# Autodesk Inventor assembly: 24567474
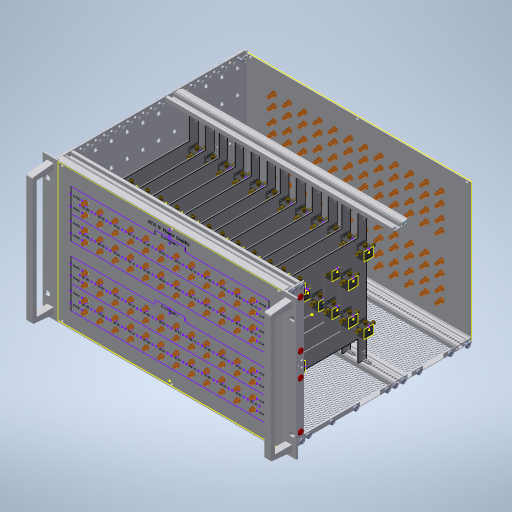
[picture p0: Inventor's stored thumbnail of the model, 512x512]
Saved by Autodesk Inventor 2024 (Build 280153000, 153)
## iProperties
Company: TraceParts S.A.
Created: 2016-07-14
Part Number: 24567474
Checked By: TraceParts S.A.
Catalog Web Link: www.traceparts.com
Description: Kit, "heavy", shielded, for backplane mounting
Vendor: Pentair/Schroff
Document SubType Name: Assembly
Designer: TraceParts
REFERENCE: 24567474
SUPPLIER: Pentair/Schroff
DESIGN: Kit, "heavy", shielded, for backplane mounting
OMNICLASS23: 23.35.33.15
TraceParts.PartVersion: 1.1.6
TraceParts.PartStatus: Published
TraceParts.PartNumber: 30-07022014-089200
TraceParts.PartLanguage: en
TraceParts.InstanceId: 30-07022014-0892005HIZ0WY7A405UN62VUZ05UA7U
TraceParts.PartTitle: Kit, "heavy", shielded, for backplane mounting
TRACEPARTS: TRACEPARTS
TraceParts.ClassPath: SCHROFF:/F_SCHROFF/SCHROFF.1/SCHROFF.1.1./SCHROFF.1.1.1/30-07022014-089200
Title: Kit, "heavy", shielded, for backplane mounting
Author: TraceParts
## Documents named in this file (110)
- C:\Users\Alexander Pollak\ownCloud\Inventor\ATA_2019\ATA_IF_PowerSplitter_6U\24567474.iam
- C:\Users\Alexander Pollak\ownCloud\Inventor\ATA_2019\ATA_IF_PowerSplitter_6U\24567474_106.ipt
- C:\Users\Alexander Pollak\ownCloud\Inventor\ATA_2019\ATA_IF_PowerSplitter_6U\24567474_105.ipt
- C:\Users\Alexander Pollak\ownCloud\Inventor\ATA_2019\ATA_IF_PowerSplitter_6U\24567474_104.ipt
- C:\Users\Alexander Pollak\ownCloud\Inventor\ATA_2019\ATA_IF_PowerSplitter_6U\24567474_103.ipt
- C:\Users\Alexander Pollak\ownCloud\Inventor\ATA_2019\ATA_IF_PowerSplitter_6U\24567474_102.ipt
- C:\Users\Alexander Pollak\ownCloud\Inventor\ATA_2019\ATA_IF_PowerSplitter_6U\24567474_101.ipt
- C:\Users\Alexander Pollak\ownCloud\Inventor\ATA_2019\ATA_IF_PowerSplitter_6U\24567474_100.ipt
- C:\Users\Alexander Pollak\ownCloud\Inventor\ATA_2019\ATA_IF_PowerSplitter_6U\24567474_99.ipt
- C:\Users\Alexander Pollak\ownCloud\Inventor\ATA_2019\ATA_IF_PowerSplitter_6U\24567474_98.ipt
- C:\Users\Alexander Pollak\ownCloud\Inventor\ATA_2019\ATA_IF_PowerSplitter_6U\24567474_97.ipt
- C:\Users\Alexander Pollak\ownCloud\Inventor\ATA_2019\ATA_IF_PowerSplitter_6U\24567474_96.ipt
- C:\Users\Alexander Pollak\ownCloud\Inventor\ATA_2019\ATA_IF_PowerSplitter_6U\24567474_95.ipt
- C:\Users\Alexander Pollak\ownCloud\Inventor\ATA_2019\ATA_IF_PowerSplitter_6U\24567474_94.ipt
- C:\Users\Alexander Pollak\ownCloud\Inventor\ATA_2019\ATA_IF_PowerSplitter_6U\24567474_93.ipt
- C:\Users\Alexander Pollak\ownCloud\Inventor\ATA_2019\ATA_IF_PowerSplitter_6U\24567474_92.ipt
- C:\Users\Alexander Pollak\ownCloud\Inventor\ATA_2019\ATA_IF_PowerSplitter_6U\24567474_91.ipt
- C:\Users\Alexander Pollak\ownCloud\Inventor\ATA_2019\ATA_IF_PowerSplitter_6U\24567474_90.ipt
- C:\Users\Alexander Pollak\ownCloud\Inventor\ATA_2019\ATA_IF_PowerSplitter_6U\24567474_89.ipt
- C:\Users\Alexander Pollak\ownCloud\Inventor\ATA_2019\ATA_IF_PowerSplitter_6U\24567474_88.ipt
- C:\Users\Alexander Pollak\ownCloud\Inventor\ATA_2019\ATA_IF_PowerSplitter_6U\24567474_87.ipt
- C:\Users\Alexander Pollak\ownCloud\Inventor\ATA_2019\ATA_IF_PowerSplitter_6U\24567474_86.ipt
- C:\Users\Alexander Pollak\ownCloud\Inventor\ATA_2019\ATA_IF_PowerSplitter_6U\24567474_85.ipt
- C:\Users\Alexander Pollak\ownCloud\Inventor\ATA_2019\ATA_IF_PowerSplitter_6U\24567474_84.ipt
- C:\Users\Alexander Pollak\ownCloud\Inventor\ATA_2019\ATA_IF_PowerSplitter_6U\24567474_83.ipt
- C:\Users\Alexander Pollak\ownCloud\Inventor\ATA_2019\ATA_IF_PowerSplitter_6U\24567474_82.ipt
- C:\Users\Alexander Pollak\ownCloud\Inventor\ATA_2019\ATA_IF_PowerSplitter_6U\24567474_81.ipt
- C:\Users\Alexander Pollak\ownCloud\Inventor\ATA_2019\ATA_IF_PowerSplitter_6U\24567474_80.ipt
- C:\Users\Alexander Pollak\ownCloud\Inventor\ATA_2019\ATA_IF_PowerSplitter_6U\24567474_79.ipt
- C:\Users\Alexander Pollak\ownCloud\Inventor\ATA_2019\ATA_IF_PowerSplitter_6U\24567474_78.ipt
- C:\Users\Alexander Pollak\ownCloud\Inventor\ATA_2019\ATA_IF_PowerSplitter_6U\24567474_77.ipt
- C:\Users\Alexander Pollak\ownCloud\Inventor\ATA_2019\ATA_IF_PowerSplitter_6U\24567474_76.ipt
- C:\Users\Alexander Pollak\ownCloud\Inventor\ATA_2019\ATA_IF_PowerSplitter_6U\24567474_75.ipt
- C:\Users\Alexander Pollak\ownCloud\Inventor\ATA_2019\ATA_IF_PowerSplitter_6U\24567474_74.ipt
- C:\Users\Alexander Pollak\ownCloud\Inventor\ATA_2019\ATA_IF_PowerSplitter_6U\24567474_73.ipt
- C:\Users\Alexander Pollak\ownCloud\Inventor\ATA_2019\ATA_IF_PowerSplitter_6U\24567474_72.ipt
- C:\Users\Alexander Pollak\ownCloud\Inventor\ATA_2019\ATA_IF_PowerSplitter_6U\24567474_71.ipt
- C:\Users\Alexander Pollak\ownCloud\Inventor\ATA_2019\ATA_IF_PowerSplitter_6U\24567474_70.ipt
- C:\Users\Alexander Pollak\ownCloud\Inventor\ATA_2019\ATA_IF_PowerSplitter_6U\24567474_69.ipt
- C:\Users\Alexander Pollak\ownCloud\Inventor\ATA_2019\ATA_IF_PowerSplitter_6U\24567474_68.ipt
- C:\Users\Alexander Pollak\ownCloud\Inventor\ATA_2019\ATA_IF_PowerSplitter_6U\24567474_67.ipt
- C:\Users\Alexander Pollak\ownCloud\Inventor\ATA_2019\ATA_IF_PowerSplitter_6U\24567474_66.ipt
- C:\Users\Alexander Pollak\ownCloud\Inventor\ATA_2019\ATA_IF_PowerSplitter_6U\24567474_65.ipt
- C:\Users\Alexander Pollak\ownCloud\Inventor\ATA_2019\ATA_IF_PowerSplitter_6U\24567474_64.ipt
- C:\Users\Alexander Pollak\ownCloud\Inventor\ATA_2019\ATA_IF_PowerSplitter_6U\24567474_63.ipt
- C:\Users\Alexander Pollak\ownCloud\Inventor\ATA_2019\ATA_IF_PowerSplitter_6U\24567474_62.ipt
- C:\Users\Alexander Pollak\ownCloud\Inventor\ATA_2019\ATA_IF_PowerSplitter_6U\24567474_61.ipt
- C:\Users\Alexander Pollak\ownCloud\Inventor\ATA_2019\ATA_IF_PowerSplitter_6U\24567474_60.ipt
- C:\Users\Alexander Pollak\ownCloud\Inventor\ATA_2019\ATA_IF_PowerSplitter_6U\24567474_59.ipt
- C:\Users\Alexander Pollak\ownCloud\Inventor\ATA_2019\ATA_IF_PowerSplitter_6U\24567474_58.ipt
- C:\Users\Alexander Pollak\ownCloud\Inventor\ATA_2019\ATA_IF_PowerSplitter_6U\24567474_57.ipt
- C:\Users\Alexander Pollak\ownCloud\Inventor\ATA_2019\ATA_IF_PowerSplitter_6U\24567474_56.ipt
- C:\Users\Alexander Pollak\ownCloud\Inventor\ATA_2019\ATA_IF_PowerSplitter_6U\24567474_55.ipt
- C:\Users\Alexander Pollak\ownCloud\Inventor\ATA_2019\ATA_IF_PowerSplitter_6U\24567474_54.ipt
- C:\Users\Alexander Pollak\ownCloud\Inventor\ATA_2019\ATA_IF_PowerSplitter_6U\24567474_53.ipt
- C:\Users\Alexander Pollak\ownCloud\Inventor\ATA_2019\ATA_IF_PowerSplitter_6U\24567474_52.ipt
- C:\Users\Alexander Pollak\ownCloud\Inventor\ATA_2019\ATA_IF_PowerSplitter_6U\24567474_51.ipt
- C:\Users\Alexander Pollak\ownCloud\Inventor\ATA_2019\ATA_IF_PowerSplitter_6U\24567474_50.ipt
- C:\Users\Alexander Pollak\ownCloud\Inventor\ATA_2019\ATA_IF_PowerSplitter_6U\24567474_49.ipt
- C:\Users\Alexander Pollak\ownCloud\Inventor\ATA_2019\ATA_IF_PowerSplitter_6U\24567474_48.ipt
- C:\Users\Alexander Pollak\ownCloud\Inventor\ATA_2019\ATA_IF_PowerSplitter_6U\24567474_47.ipt
- C:\Users\Alexander Pollak\ownCloud\Inventor\ATA_2019\ATA_IF_PowerSplitter_6U\24567474_46.ipt
- C:\Users\Alexander Pollak\ownCloud\Inventor\ATA_2019\ATA_IF_PowerSplitter_6U\24567474_45.ipt
- C:\Users\Alexander Pollak\ownCloud\Inventor\ATA_2019\ATA_IF_PowerSplitter_6U\24567474_44.ipt
- C:\Users\Alexander Pollak\ownCloud\Inventor\ATA_2019\ATA_IF_PowerSplitter_6U\24567474_43.ipt
- C:\Users\Alexander Pollak\ownCloud\Inventor\ATA_2019\ATA_IF_PowerSplitter_6U\24567474_42.ipt
- C:\Users\Alexander Pollak\ownCloud\Inventor\ATA_2019\ATA_IF_PowerSplitter_6U\24567474_41.ipt
- C:\Users\Alexander Pollak\ownCloud\Inventor\ATA_2019\ATA_IF_PowerSplitter_6U\24567474_40.ipt
- C:\Users\Alexander Pollak\ownCloud\Inventor\ATA_2019\ATA_IF_PowerSplitter_6U\24567474_39.ipt
- C:\Users\Alexander Pollak\ownCloud\Inventor\ATA_2019\ATA_IF_PowerSplitter_6U\24567474_38.ipt
- C:\Users\Alexander Pollak\ownCloud\Inventor\ATA_2019\ATA_IF_PowerSplitter_6U\24567474_37.ipt
- C:\Users\Alexander Pollak\ownCloud\Inventor\ATA_2019\ATA_IF_PowerSplitter_6U\24567474_36.ipt
- C:\Users\Alexander Pollak\ownCloud\Inventor\ATA_2019\ATA_IF_PowerSplitter_6U\24567474_35.ipt
- C:\Users\Alexander Pollak\ownCloud\Inventor\ATA_2019\ATA_IF_PowerSplitter_6U\24567474_34.ipt
- C:\Users\Alexander Pollak\ownCloud\Inventor\ATA_2019\ATA_IF_PowerSplitter_6U\24567474_33.ipt
- C:\Users\Alexander Pollak\ownCloud\Inventor\ATA_2019\ATA_IF_PowerSplitter_6U\24567474_32.ipt
- C:\Users\Alexander Pollak\ownCloud\Inventor\ATA_2019\ATA_IF_PowerSplitter_6U\24567474_31.ipt
- C:\Users\Alexander Pollak\ownCloud\Inventor\ATA_2019\ATA_IF_PowerSplitter_6U\24567474_30.ipt
- C:\Users\Alexander Pollak\ownCloud\Inventor\ATA_2019\ATA_IF_PowerSplitter_6U\24567474_29.ipt
- C:\Users\Alexander Pollak\ownCloud\Inventor\ATA_2019\ATA_IF_PowerSplitter_6U\24567474_28.ipt
- C:\Users\Alexander Pollak\ownCloud\Inventor\ATA_2019\ATA_IF_PowerSplitter_6U\24567474_27.ipt
- C:\Users\Alexander Pollak\ownCloud\Inventor\ATA_2019\ATA_IF_PowerSplitter_6U\24567474_26.ipt
- C:\Users\Alexander Pollak\ownCloud\Inventor\ATA_2019\ATA_IF_PowerSplitter_6U\24567474_25.ipt
- C:\Users\Alexander Pollak\ownCloud\Inventor\ATA_2019\ATA_IF_PowerSplitter_6U\24567474_24.ipt
- C:\Users\Alexander Pollak\ownCloud\Inventor\ATA_2019\ATA_IF_PowerSplitter_6U\24567474_23.ipt
- C:\Users\Alexander Pollak\ownCloud\Inventor\ATA_2019\ATA_IF_PowerSplitter_6U\24567474_22.ipt
- C:\Users\Alexander Pollak\ownCloud\Inventor\ATA_2019\ATA_IF_PowerSplitter_6U\24567474_21.ipt
- C:\Users\Alexander Pollak\ownCloud\Inventor\ATA_2019\ATA_IF_PowerSplitter_6U\24567474_20.ipt
- C:\Users\Alexander Pollak\ownCloud\Inventor\ATA_2019\ATA_IF_PowerSplitter_6U\24567474_19.ipt
- C:\Users\Alexander Pollak\ownCloud\Inventor\ATA_2019\ATA_IF_PowerSplitter_6U\24567474_18.ipt
- C:\Users\Alexander Pollak\ownCloud\Inventor\ATA_2019\ATA_IF_PowerSplitter_6U\24567474_17.ipt
- C:\Users\Alexander Pollak\ownCloud\Inventor\ATA_2019\ATA_IF_PowerSplitter_6U\24567474_16.ipt
- C:\Users\Alexander Pollak\ownCloud\Inventor\ATA_2019\ATA_IF_PowerSplitter_6U\24567474_15.ipt
- C:\Users\Alexander Pollak\ownCloud\Inventor\ATA_2019\ATA_IF_PowerSplitter_6U\24567474_14.ipt
- C:\Users\Alexander Pollak\ownCloud\Inventor\ATA_2019\ATA_IF_PowerSplitter_6U\24567474_13.ipt
- C:\Users\Alexander Pollak\ownCloud\Inventor\ATA_2019\ATA_IF_PowerSplitter_6U\24567474_12.ipt
- C:\Users\Alexander Pollak\ownCloud\Inventor\ATA_2019\ATA_IF_PowerSplitter_6U\24567474_11.ipt
- C:\Users\Alexander Pollak\ownCloud\Inventor\ATA_2019\ATA_IF_PowerSplitter_6U\24567474_10.ipt
- C:\Users\Alexander Pollak\ownCloud\Inventor\ATA_2019\ATA_IF_PowerSplitter_6U\24567474_09.ipt
- C:\Users\Alexander Pollak\ownCloud\Inventor\ATA_2019\ATA_IF_PowerSplitter_6U\24567474_08.ipt
- C:\Users\Alexander Pollak\ownCloud\Inventor\ATA_2019\ATA_IF_PowerSplitter_6U\24567474_07.ipt
- C:\Users\Alexander Pollak\ownCloud\Inventor\ATA_2019\ATA_IF_PowerSplitter_6U\24567474_06.ipt
- C:\Users\Alexander Pollak\ownCloud\Inventor\ATA_2019\ATA_IF_PowerSplitter_6U\24567474_05.ipt
- C:\Users\Alexander Pollak\ownCloud\Inventor\ATA_2019\ATA_IF_PowerSplitter_6U\24567474_04.ipt
- C:\Users\Alexander Pollak\ownCloud\Inventor\ATA_2019\ATA_IF_PowerSplitter_6U\24567474_03.ipt
- C:\Users\Alexander Pollak\ownCloud\Inventor\ATA_2019\ATA_IF_PowerSplitter_6U\24567474_02.ipt
- C:\Users\Alexander Pollak\ownCloud\Inventor\ATA_2019\ATA_IF_PowerSplitter_6U\24567474_01.ipt
- C:\Users\Alexander Pollak\ownCloud\Inventor\ATA_2019\ATA_IF_PowerSplitter_6U\24567474_110.ipt
- C:\Users\Alexander Pollak\ownCloud\Inventor\ATA_2019\Shared_Parts\r125720001.ipt
- C:\Users\Alexander Pollak\ownCloud\Inventor\ATA_2019\ATA_IF_PowerSplitter_6U\Custom Parts\power-splitter-plate.iam
## Components (311 placed, 109 different names)
1. 24567474_110:1 — Mate:1, Mate:2, Mate:3, Insert:1, Insert:2, Insert:3, Insert:4, Insert:5, Insert:6, Insert:7, Insert:8, Insert:9, Insert:10, Insert:11, Insert:12, Insert:13, Insert:14, Insert:15, Insert:16, Insert:17, Insert:18, Insert:19, Insert:20, Insert:21, Insert:22, Insert:23, Insert:24, Insert:25, Insert:26, Insert:27, Insert:28, Insert:29, Insert:30, Insert:31, Insert:32, Insert:33, Insert:34, Insert:35, Insert:36, Insert:37, Insert:38, Insert:39, Insert:40, Insert:41, Insert:42, Insert:43, Insert:44, Insert:45, Insert:46, Insert:47, Insert:48, Insert:49, Insert:50, Insert:51, Insert:52, Insert:53, Insert:54, Insert:55, Insert:56, Insert:57, Insert:58, Insert:59, Insert:60, Insert:61, Insert:62, Insert:63, Insert:64, Insert:65, Insert:66, Insert:67, Insert:68, Insert:69, Insert:70, Insert:71, Insert:72, Insert:73, Insert:74, Insert:75, Insert:76, Insert:77, Insert:78, Insert:79, Insert:80, Insert:81, Insert:82, Insert:83, Insert:84, Insert:85, Insert:86, Insert:87, Insert:88, Insert:89, Insert:90, Insert:91, Insert:92, Insert:93, Insert:94, Insert:95, Insert:96
2. 24567474_106:1
3. 24567474_105:1
4. 24567474_104:1 — Mate:3
5. 24567474_103:1
6. 24567474_102:1
7. 24567474_101:1
8. 24567474_100:1 — Insert:97, Insert:98, Insert:99, Insert:100, Insert:101, Insert:102, Insert:103, Insert:104, Insert:105, Insert:106, Insert:107, Insert:108, Insert:109, Insert:110, Insert:111, Insert:112, Insert:113, Insert:114, Insert:115, Insert:116, Insert:117, Insert:118, Insert:119, Insert:120, Insert:121, Insert:122, Insert:123, Insert:124, Insert:125, Insert:126, Insert:127, Insert:128, Insert:129, Insert:130, Insert:131, Insert:132, Insert:133, Insert:134, Insert:135, Insert:136, Insert:137, Insert:138, Insert:139, Insert:140, Insert:141, Insert:142, Insert:143, Insert:144, Insert:145, Insert:146, Insert:147, Insert:148, Insert:149, Insert:150, Insert:151, Insert:152, Insert:153, Insert:154, Insert:155, Insert:156, Insert:157, Insert:158, Insert:159, Insert:160, Insert:161, Insert:162, Insert:163, Insert:164, Insert:165, Insert:166, Insert:167, Insert:168, Insert:169, Insert:170, Insert:171, Insert:172, Insert:173, Insert:174, Insert:175, Insert:176, Insert:177, Insert:178, Insert:179, Insert:180, Insert:181, Insert:182, Insert:183, Insert:184, Insert:185, Insert:186, Insert:187, Insert:188, Insert:189, Insert:190, Insert:191, Insert:192
9. 24567474_99:1
10. 24567474_98:1
11. 24567474_97:1
12. 24567474_96:1
13. 24567474_95:1
14. 24567474_94:1
15. 24567474_93:1
16. 24567474_92:1
17. 24567474_91:1
18. 24567474_90:1
19. 24567474_89:1
20. 24567474_88:1
21. 24567474_87:1
22. 24567474_86:1
23. 24567474_85:1
24. 24567474_84:1
25. 24567474_83:1
26. 24567474_82:1
27. 24567474_81:1
28. 24567474_80:1
29. 24567474_79:1
30. 24567474_78:1
31. 24567474_77:1
32. 24567474_76:1
33. 24567474_75:1
34. 24567474_74:1
35. 24567474_73:1
36. 24567474_72:1
37. 24567474_71:1
38. 24567474_70:1 — Mate:4, Mate:6, Mate:8, Mate:10, Mate:12, Mate:14, Mate:16, Mate:18, Mate:20, Mate:22, Mate:24, Mate:26
39. 24567474_69:1 — Tangent:1, Tangent:2, Tangent:3, Tangent:4, Tangent:5, Tangent:6, Tangent:7, Tangent:8, Tangent:9, Tangent:10, Tangent:11, Tangent:12
40. 24567474_68:1
41. 24567474_67:1
42. 24567474_66:1
43. 24567474_65:1
44. 24567474_64:1
45. 24567474_63:1
46. 24567474_62:1
47. 24567474_61:1
48. 24567474_60:1
49. 24567474_59:1
50. 24567474_58:1
51. 24567474_57:1 — Mate:1
52. 24567474_56:1
53. 24567474_55:1
54. 24567474_54:1
55. 24567474_53:1
56. 24567474_52:1
57. 24567474_51:1
58. 24567474_50:1
59. 24567474_49:1
60. 24567474_48:1
61. 24567474_47:1
62. 24567474_46:1 — Mate:2, Mate:5, Mate:7, Mate:9, Mate:11, Mate:13, Mate:15, Mate:17, Mate:19, Mate:21, Mate:23, Mate:25, Mate:27
63. 24567474_45:1
64. 24567474_44:1
65. 24567474_43:1
66. 24567474_42:1
67. 24567474_41:1
68. 24567474_40:1
69. 24567474_39:1
70. 24567474_38:1
71. 24567474_37:1
72. 24567474_36:1
73. 24567474_35:1
74. 24567474_34:1
75. 24567474_33:1
76. 24567474_32:1
77. 24567474_31:1
78. 24567474_30:1
79. 24567474_29:1
80. 24567474_28:1
81. 24567474_27:1
82. 24567474_26:1
83. 24567474_25:1
84. 24567474_24:1
85. 24567474_23:1
86. 24567474_22:1
87. 24567474_21:1
88. 24567474_20:1
89. 24567474_19:1
90. 24567474_18:1
91. 24567474_17:1
92. 24567474_16:1
93. 24567474_15:1
94. 24567474_14:1
95. 24567474_13:1
96. 24567474_12:1
97. 24567474_11:1
98. 24567474_10:1
99. 24567474_09:1
100. 24567474_08:1
101. 24567474_07:1
102. 24567474_06:1
103. 24567474_05:1
104. 24567474_04:1
105. 24567474_03:1
106. 24567474_02:1
107. 24567474_01:1
108. r125720001:13 — Insert:45
109. r125720001:14 — Insert:46
110. r125720001:15 — Insert:47
111. r125720001:16 — Insert:48
112. r125720001:17 — Insert:39
113. r125720001:18 — Insert:37
114. r125720001:19 — Insert:36
115. r125720001:20 — Insert:35
116. r125720001:21 — Insert:32
117. r125720001:22 — Insert:30
118. r125720001:23 — Insert:28
119. r125720001:24 — Insert:26
120. r125720001:25 — Insert:44
121. r125720001:26 — Insert:43
122. r125720001:27 — Insert:42
123. r125720001:28 — Insert:41
124. r125720001:29 — Insert:40
125. r125720001:30 — Insert:38
126. r125720001:31 — Insert:34
127. r125720001:32 — Insert:33
128. r125720001:33 — Insert:31
129. r125720001:34 — Insert:29
130. r125720001:35 — Insert:27
131. r125720001:36 — Insert:25
132. r125720001:37 — Insert:13
133. r125720001:38 — Insert:14
134. r125720001:39 — Insert:15
135. r125720001:40 — Insert:16
136. r125720001:41 — Insert:17
137. r125720001:42 — Insert:18
138. r125720001:43 — Insert:19
139. r125720001:44 — Insert:20
140. r125720001:45 — Insert:21
141. r125720001:46 — Insert:22
142. r125720001:47 — Insert:23
143. r125720001:48 — Insert:24
144. r125720001:2 — Insert:2
145. r125720001:3 — Insert:8
146. r125720001:4 — Insert:10
147. r125720001:5 — Insert:11
148. r125720001:6 — Insert:12
149. r125720001:7 — Insert:4
150. r125720001:8 — Insert:3
151. r125720001:9 — Insert:5
152. r125720001:10 — Insert:6
153. r125720001:11 — Insert:7
154. r125720001:12 — Insert:9
155. r125720001:1 — Insert:1
156. r125720001:49 — Insert:49
157. r125720001:50 — Insert:50
158. r125720001:51 — Insert:63
159. r125720001:52 — Insert:64
160. r125720001:53 — Insert:69
161. r125720001:54 — Insert:70
162. r125720001:55 — Insert:73
163. r125720001:56 — Insert:74
164. r125720001:57 — Insert:96
165. r125720001:58 — Insert:95
166. r125720001:59 — Insert:94
167. r125720001:60 — Insert:93
168. r125720001:61 — Insert:51
169. r125720001:62 — Insert:56
170. r125720001:63 — Insert:62
171. r125720001:64 — Insert:65
172. r125720001:65 — Insert:68
173. r125720001:66 — Insert:71
174. r125720001:67 — Insert:92
175. r125720001:68 — Insert:91
176. r125720001:69 — Insert:90
177. r125720001:70 — Insert:89
178. r125720001:71 — Insert:88
179. r125720001:72 — Insert:82
180. r125720001:73 — Insert:53
181. r125720001:74 — Insert:55
182. r125720001:75 — Insert:61
183. r125720001:76 — Insert:66
184. r125720001:77 — Insert:67
185. r125720001:78 — Insert:72
186. r125720001:79 — Insert:87
187. r125720001:80 — Insert:86
188. r125720001:81 — Insert:85
189. r125720001:82 — Insert:84
190. r125720001:83 — Insert:83
191. r125720001:84 — Insert:81
192. r125720001:85 — Insert:52
193. r125720001:86 — Insert:54
194. r125720001:87 — Insert:57
195. r125720001:88 — Insert:58
196. r125720001:89 — Insert:59
197. r125720001:90 — Insert:60
198. r125720001:91 — Insert:75
199. r125720001:92 — Insert:76
200. r125720001:93 — Insert:77
201. r125720001:94 — Insert:78
202. r125720001:95 — Insert:79
203. r125720001:96 — Insert:80
204. r125720001:97 — Insert:104
205. r125720001:98 — Insert:107
206. r125720001:99 — Insert:110
207. r125720001:100 — Insert:111
208. r125720001:101 — Insert:122
209. r125720001:102 — Insert:121
210. r125720001:103 — Insert:120
211. r125720001:104 — Insert:119
212. r125720001:105 — Insert:118
213. r125720001:106 — Insert:117
214. r125720001:107 — Insert:114
215. r125720001:108 — Insert:113
216. r125720001:109 — Insert:103
217. r125720001:110 — Insert:106
218. r125720001:111 — Insert:109
219. r125720001:112 — Insert:144
220. r125720001:113 — Insert:143
221. r125720001:114 — Insert:142
222. r125720001:115 — Insert:137
223. r125720001:116 — Insert:135
224. r125720001:117 — Insert:133
225. r125720001:118 — Insert:123
226. r125720001:119 — Insert:116
227. r125720001:120 — Insert:112
228. r125720001:121 — Insert:102
229. r125720001:122 — Insert:105
230. r125720001:123 — Insert:108
231. r125720001:124 — Insert:141
232. r125720001:125 — Insert:140
233. r125720001:126 — Insert:139
234. r125720001:127 — Insert:138
235. r125720001:128 — Insert:136
236. r125720001:129 — Insert:134
237. r125720001:130 — Insert:132
238. r125720001:131 — Insert:131
239. r125720001:132 — Insert:115
240. r125720001:133 — Insert:98
241. r125720001:134 — Insert:99
242. r125720001:135 — Insert:100
243. r125720001:136 — Insert:101
244. r125720001:137 — Insert:130
245. r125720001:138 — Insert:129
246. r125720001:139 — Insert:128
247. r125720001:140 — Insert:127
248. r125720001:141 — Insert:126
249. r125720001:142 — Insert:125
250. r125720001:143 — Insert:124
251. r125720001:144 — Insert:97
252. r125720001:145 — Insert:151
253. r125720001:146 — Insert:152
254. r125720001:147 — Insert:157
255. r125720001:148 — Insert:162
256. r125720001:149 — Insert:164
257. r125720001:150 — Insert:165
258. r125720001:151 — Insert:166
259. r125720001:152 — Insert:167
260. r125720001:153 — Insert:173
261. r125720001:154 — Insert:174
262. r125720001:155 — Insert:175
263. r125720001:156 — Insert:176
264. r125720001:157 — Insert:188
265. r125720001:158 — Insert:189
266. r125720001:159 — Insert:190
267. r125720001:160 — Insert:191
268. r125720001:161 — Insert:192
269. r125720001:162 — Insert:172
270. r125720001:163 — Insert:170
271. r125720001:164 — Insert:169
272. r125720001:165 — Insert:163
273. r125720001:166 — Insert:158
274. r125720001:167 — Insert:153
275. r125720001:168 — Insert:150
276. r125720001:169 — Insert:179
277. r125720001:170 — Insert:187
278. r125720001:171 — Insert:186
279. r125720001:172 — Insert:185
280. r125720001:173 — Insert:182
281. r125720001:174 — Insert:181
282. r125720001:175 — Insert:171
283. r125720001:176 — Insert:168
284. r125720001:177 — Insert:159
285. r125720001:178 — Insert:154
286. r125720001:179 — Insert:149
287. r125720001:180 — Insert:146
288. r125720001:181 — Insert:177
289. r125720001:182 — Insert:178
290. r125720001:183 — Insert:184
291. r125720001:184 — Insert:183
292. r125720001:185 — Insert:180
293. r125720001:186 — Insert:161
294. r125720001:187 — Insert:160
295. r125720001:188 — Insert:156
296. r125720001:189 — Insert:155
297. r125720001:190 — Insert:148
298. r125720001:191 — Insert:147
299. r125720001:192 — Insert:145
300. power-splitter-plate:12 [sub-assembly] — Mate:26, Mate:27, Tangent:12
301. power-splitter-plate:11 [sub-assembly] — Mate:24, Mate:25, Tangent:11
302. power-splitter-plate:10 [sub-assembly] — Mate:22, Mate:23, Tangent:10
303. power-splitter-plate:9 [sub-assembly] — Mate:20, Mate:21, Tangent:9
304. power-splitter-plate:8 [sub-assembly] — Mate:18, Mate:19, Tangent:8
305. power-splitter-plate:7 [sub-assembly] — Mate:16, Mate:17, Tangent:7
306. power-splitter-plate:6 [sub-assembly] — Mate:14, Mate:15, Tangent:6
307. power-splitter-plate:5 [sub-assembly] — Mate:12, Mate:13, Tangent:5
308. power-splitter-plate:4 [sub-assembly] — Mate:10, Mate:11, Tangent:4
309. power-splitter-plate:3 [sub-assembly] — Mate:8, Mate:9, Tangent:3
310. power-splitter-plate:2 [sub-assembly] — Mate:6, Mate:7, Tangent:2
311. power-splitter-plate:1 [sub-assembly] — Mate:4, Mate:5, Tangent:1
## Relationships (231: Insert 192, Mate 27, Tangent 12)
- Mate:1: 24567474_110:1 ↔ 24567474_57:1
- Mate:2 (0.55 mm): 24567474_110:1 ↔ 24567474_46:1
- Mate:3 (0.25 mm): 24567474_110:1 ↔ 24567474_104:1
- Insert:1: 24567474_110:1 ↔ r125720001:1
- Insert:2: 24567474_110:1 ↔ r125720001:2
- Insert:3: 24567474_110:1 ↔ r125720001:8
- Insert:4: 24567474_110:1 ↔ r125720001:7
- Insert:5: 24567474_110:1 ↔ r125720001:9
- Insert:6: 24567474_110:1 ↔ r125720001:10
- Insert:7: 24567474_110:1 ↔ r125720001:11
- Insert:8: 24567474_110:1 ↔ r125720001:3
- Insert:9: 24567474_110:1 ↔ r125720001:12
- Insert:10: 24567474_110:1 ↔ r125720001:4
- Insert:11: 24567474_110:1 ↔ r125720001:5
- Insert:12: 24567474_110:1 ↔ r125720001:6
- Insert:13: 24567474_110:1 ↔ r125720001:37
- Insert:14: 24567474_110:1 ↔ r125720001:38
- Insert:15: 24567474_110:1 ↔ r125720001:39
- Insert:16: 24567474_110:1 ↔ r125720001:40
- Insert:17: 24567474_110:1 ↔ r125720001:41
- Insert:18: 24567474_110:1 ↔ r125720001:42
- Insert:19: 24567474_110:1 ↔ r125720001:43
- Insert:20: 24567474_110:1 ↔ r125720001:44
- Insert:21: 24567474_110:1 ↔ r125720001:45
- Insert:22: 24567474_110:1 ↔ r125720001:46
- Insert:23: 24567474_110:1 ↔ r125720001:47
- Insert:24: 24567474_110:1 ↔ r125720001:48
- Insert:25: 24567474_110:1 ↔ r125720001:36
- Insert:26: 24567474_110:1 ↔ r125720001:24
- Insert:27: 24567474_110:1 ↔ r125720001:35
- Insert:28: 24567474_110:1 ↔ r125720001:23
- Insert:29: 24567474_110:1 ↔ r125720001:34
- Insert:30: 24567474_110:1 ↔ r125720001:22
- Insert:31: 24567474_110:1 ↔ r125720001:33
- Insert:32: 24567474_110:1 ↔ r125720001:21
- Insert:33: 24567474_110:1 ↔ r125720001:32
- Insert:34: 24567474_110:1 ↔ r125720001:31
- Insert:35: 24567474_110:1 ↔ r125720001:20
- Insert:36: 24567474_110:1 ↔ r125720001:19
- Insert:37: 24567474_110:1 ↔ r125720001:18
- Insert:38: 24567474_110:1 ↔ r125720001:30
- Insert:39: 24567474_110:1 ↔ r125720001:17
- Insert:40: 24567474_110:1 ↔ r125720001:29
- Insert:41: 24567474_110:1 ↔ r125720001:28
- Insert:42: 24567474_110:1 ↔ r125720001:27
- Insert:43: 24567474_110:1 ↔ r125720001:26
- Insert:44: 24567474_110:1 ↔ r125720001:25
- Insert:45: 24567474_110:1 ↔ r125720001:13
- Insert:46: 24567474_110:1 ↔ r125720001:14
- Insert:47: 24567474_110:1 ↔ r125720001:15
- Insert:48: 24567474_110:1 ↔ r125720001:16
- Insert:49: 24567474_110:1 ↔ r125720001:49
- Insert:50: 24567474_110:1 ↔ r125720001:50
- Insert:51: 24567474_110:1 ↔ r125720001:61
- Insert:52: 24567474_110:1 ↔ r125720001:85
- Insert:53: 24567474_110:1 ↔ r125720001:73
- Insert:54: 24567474_110:1 ↔ r125720001:86
- Insert:55: 24567474_110:1 ↔ r125720001:74
- Insert:56: 24567474_110:1 ↔ r125720001:62
- Insert:57: 24567474_110:1 ↔ r125720001:87
- Insert:58: 24567474_110:1 ↔ r125720001:88
- Insert:59: 24567474_110:1 ↔ r125720001:89
- Insert:60: 24567474_110:1 ↔ r125720001:90
- Insert:61: 24567474_110:1 ↔ r125720001:75
- Insert:62: 24567474_110:1 ↔ r125720001:63
- Insert:63: 24567474_110:1 ↔ r125720001:51
- Insert:64: 24567474_110:1 ↔ r125720001:52
- Insert:65: 24567474_110:1 ↔ r125720001:64
- Insert:66: 24567474_110:1 ↔ r125720001:76
- Insert:67: 24567474_110:1 ↔ r125720001:77
- Insert:68: 24567474_110:1 ↔ r125720001:65
- Insert:69: 24567474_110:1 ↔ r125720001:53
- Insert:70: 24567474_110:1 ↔ r125720001:54
- Insert:71: 24567474_110:1 ↔ r125720001:66
- Insert:72: 24567474_110:1 ↔ r125720001:78
- Insert:73: 24567474_110:1 ↔ r125720001:55
- Insert:74: 24567474_110:1 ↔ r125720001:56
- Insert:75: 24567474_110:1 ↔ r125720001:91
- Insert:76: 24567474_110:1 ↔ r125720001:92
- Insert:77: 24567474_110:1 ↔ r125720001:93
- Insert:78: 24567474_110:1 ↔ r125720001:94
- Insert:79: 24567474_110:1 ↔ r125720001:95
- Insert:80: 24567474_110:1 ↔ r125720001:96
- Insert:81: 24567474_110:1 ↔ r125720001:84
- Insert:82: 24567474_110:1 ↔ r125720001:72
- Insert:83: 24567474_110:1 ↔ r125720001:83
- Insert:84: 24567474_110:1 ↔ r125720001:82
- Insert:85: 24567474_110:1 ↔ r125720001:81
- Insert:86: 24567474_110:1 ↔ r125720001:80
- Insert:87: 24567474_110:1 ↔ r125720001:79
- Insert:88: 24567474_110:1 ↔ r125720001:71
- Insert:89: 24567474_110:1 ↔ r125720001:70
- Insert:90: 24567474_110:1 ↔ r125720001:69
- Insert:91: 24567474_110:1 ↔ r125720001:68
- Insert:92: 24567474_110:1 ↔ r125720001:67
- Insert:93: 24567474_110:1 ↔ r125720001:60
- Insert:94: 24567474_110:1 ↔ r125720001:59
- Insert:95: 24567474_110:1 ↔ r125720001:58
- Insert:96: 24567474_110:1 ↔ r125720001:57
- Insert:97: 24567474_100:1 ↔ r125720001:144
- Insert:98: 24567474_100:1 ↔ r125720001:133
- Insert:99: 24567474_100:1 ↔ r125720001:134
- Insert:100: 24567474_100:1 ↔ r125720001:135
- Insert:101: 24567474_100:1 ↔ r125720001:136
- Insert:102: 24567474_100:1 ↔ r125720001:121
- Insert:103: 24567474_100:1 ↔ r125720001:109
- Insert:104: 24567474_100:1 ↔ r125720001:97
- Insert:105: 24567474_100:1 ↔ r125720001:122
- Insert:106: 24567474_100:1 ↔ r125720001:110
- Insert:107: 24567474_100:1 ↔ r125720001:98
- Insert:108: 24567474_100:1 ↔ r125720001:123
- Insert:109: 24567474_100:1 ↔ r125720001:111
- Insert:110: 24567474_100:1 ↔ r125720001:99
- Insert:111: 24567474_100:1 ↔ r125720001:100
- Insert:112: 24567474_100:1 ↔ r125720001:120
- Insert:113: 24567474_100:1 ↔ r125720001:108
- Insert:114: 24567474_100:1 ↔ r125720001:107
- Insert:115: 24567474_100:1 ↔ r125720001:132
- Insert:116: 24567474_100:1 ↔ r125720001:119
- Insert:117: 24567474_100:1 ↔ r125720001:106
- Insert:118: 24567474_100:1 ↔ r125720001:105
- Insert:119: 24567474_100:1 ↔ r125720001:104
- Insert:120: 24567474_100:1 ↔ r125720001:103
- Insert:121: 24567474_100:1 ↔ r125720001:102
- Insert:122: 24567474_100:1 ↔ r125720001:101
- Insert:123: 24567474_100:1 ↔ r125720001:118
- Insert:124: 24567474_100:1 ↔ r125720001:143
- Insert:125: 24567474_100:1 ↔ r125720001:142
- Insert:126: 24567474_100:1 ↔ r125720001:141
- Insert:127: 24567474_100:1 ↔ r125720001:140
- Insert:128: 24567474_100:1 ↔ r125720001:139
- Insert:129: 24567474_100:1 ↔ r125720001:138
- Insert:130: 24567474_100:1 ↔ r125720001:137
- Insert:131: 24567474_100:1 ↔ r125720001:131
- Insert:132: 24567474_100:1 ↔ r125720001:130
- Insert:133: 24567474_100:1 ↔ r125720001:117
- Insert:134: 24567474_100:1 ↔ r125720001:129
- Insert:135: 24567474_100:1 ↔ r125720001:116
- Insert:136: 24567474_100:1 ↔ r125720001:128
- Insert:137: 24567474_100:1 ↔ r125720001:115
- Insert:138: 24567474_100:1 ↔ r125720001:127
- Insert:139: 24567474_100:1 ↔ r125720001:126
- Insert:140: 24567474_100:1 ↔ r125720001:125
- Insert:141: 24567474_100:1 ↔ r125720001:124
- Insert:142: 24567474_100:1 ↔ r125720001:114
- Insert:143: 24567474_100:1 ↔ r125720001:113
- Insert:144: 24567474_100:1 ↔ r125720001:112
- Insert:145: 24567474_100:1 ↔ r125720001:192
- Insert:146: 24567474_100:1 ↔ r125720001:180
- Insert:147: 24567474_100:1 ↔ r125720001:191
- Insert:148: 24567474_100:1 ↔ r125720001:190
- Insert:149: 24567474_100:1 ↔ r125720001:179
- Insert:150: 24567474_100:1 ↔ r125720001:168
- Insert:151: 24567474_100:1 ↔ r125720001:145
- Insert:152: 24567474_100:1 ↔ r125720001:146
- Insert:153: 24567474_100:1 ↔ r125720001:167
- Insert:154: 24567474_100:1 ↔ r125720001:178
- Insert:155: 24567474_100:1 ↔ r125720001:189
- Insert:156: 24567474_100:1 ↔ r125720001:188
- Insert:157: 24567474_100:1 ↔ r125720001:147
- Insert:158: 24567474_100:1 ↔ r125720001:166
- Insert:159: 24567474_100:1 ↔ r125720001:177
- Insert:160: 24567474_100:1 ↔ r125720001:187
- Insert:161: 24567474_100:1 ↔ r125720001:186
- Insert:162: 24567474_100:1 ↔ r125720001:148
- Insert:163: 24567474_100:1 ↔ r125720001:165
- Insert:164: 24567474_100:1 ↔ r125720001:149
- Insert:165: 24567474_100:1 ↔ r125720001:150
- Insert:166: 24567474_100:1 ↔ r125720001:151
- Insert:167: 24567474_100:1 ↔ r125720001:152
- Insert:168: 24567474_100:1 ↔ r125720001:176
- Insert:169: 24567474_100:1 ↔ r125720001:164
- Insert:170: 24567474_100:1 ↔ r125720001:163
- Insert:171: 24567474_100:1 ↔ r125720001:175
- Insert:172: 24567474_100:1 ↔ r125720001:162
- Insert:173: 24567474_100:1 ↔ r125720001:153
- Insert:174: 24567474_100:1 ↔ r125720001:154
- Insert:175: 24567474_100:1 ↔ r125720001:155
- Insert:176: 24567474_100:1 ↔ r125720001:156
- Insert:177: 24567474_100:1 ↔ r125720001:181
- Insert:178: 24567474_100:1 ↔ r125720001:182
- Insert:179: 24567474_100:1 ↔ r125720001:169
- Insert:180: 24567474_100:1 ↔ r125720001:185
- Insert:181: 24567474_100:1 ↔ r125720001:174
- Insert:182: 24567474_100:1 ↔ r125720001:173
- Insert:183: 24567474_100:1 ↔ r125720001:184
- Insert:184: 24567474_100:1 ↔ r125720001:183
- Insert:185: 24567474_100:1 ↔ r125720001:172
- Insert:186: 24567474_100:1 ↔ r125720001:171
- Insert:187: 24567474_100:1 ↔ r125720001:170
- Insert:188: 24567474_100:1 ↔ r125720001:157
- Insert:189: 24567474_100:1 ↔ r125720001:158
- Insert:190: 24567474_100:1 ↔ r125720001:159
- Insert:191: 24567474_100:1 ↔ r125720001:160
- Insert:192: 24567474_100:1 ↔ r125720001:161
- Mate:4: 24567474_70:1 ↔ power-splitter-plate:1
- Mate:5: 24567474_46:1 ↔ power-splitter-plate:1
- Tangent:1 (0.5 mm): 24567474_69:1 ↔ power-splitter-plate:1
- Mate:6: 24567474_70:1 ↔ power-splitter-plate:2
- Mate:7: 24567474_46:1 ↔ power-splitter-plate:2
- Tangent:2 (0.5 mm): 24567474_69:1 ↔ power-splitter-plate:2
- Mate:8: 24567474_70:1 ↔ power-splitter-plate:3
- Mate:9: 24567474_46:1 ↔ power-splitter-plate:3
- Tangent:3 (0.5 mm): 24567474_69:1 ↔ power-splitter-plate:3
- Mate:10: 24567474_70:1 ↔ power-splitter-plate:4
- Mate:11: 24567474_46:1 ↔ power-splitter-plate:4
- Tangent:4 (0.5 mm): 24567474_69:1 ↔ power-splitter-plate:4
- Mate:12: 24567474_70:1 ↔ power-splitter-plate:5
- Mate:13: 24567474_46:1 ↔ power-splitter-plate:5
- Mate:14: 24567474_70:1 ↔ power-splitter-plate:6
- Mate:15: 24567474_46:1 ↔ power-splitter-plate:6
- Mate:16: 24567474_70:1 ↔ power-splitter-plate:7
- Mate:17: 24567474_46:1 ↔ power-splitter-plate:7
- Mate:18: 24567474_70:1 ↔ power-splitter-plate:8
- Mate:19: 24567474_46:1 ↔ power-splitter-plate:8
- Mate:20: 24567474_70:1 ↔ power-splitter-plate:9
- Mate:21: 24567474_46:1 ↔ power-splitter-plate:9
- Mate:22: 24567474_70:1 ↔ power-splitter-plate:10
- Mate:23: 24567474_46:1 ↔ power-splitter-plate:10
- Tangent:5 (0.5 mm): 24567474_69:1 ↔ power-splitter-plate:5
- Tangent:6 (0.5 mm): 24567474_69:1 ↔ power-splitter-plate:6
- Tangent:7 (0.5 mm): 24567474_69:1 ↔ power-splitter-plate:7
- Tangent:8 (0.5 mm): 24567474_69:1 ↔ power-splitter-plate:8
- Tangent:9 (0.5 mm): 24567474_69:1 ↔ power-splitter-plate:9
- Tangent:10 (0.5 mm): 24567474_69:1 ↔ power-splitter-plate:10
- Mate:24: 24567474_70:1 ↔ power-splitter-plate:11
- Mate:25: 24567474_46:1 ↔ power-splitter-plate:11
- Mate:26: 24567474_70:1 ↔ power-splitter-plate:12
- Mate:27: 24567474_46:1 ↔ power-splitter-plate:12
- Tangent:11 (0.5 mm): 24567474_69:1 ↔ power-splitter-plate:11
- Tangent:12 (0.5 mm): 24567474_69:1 ↔ power-splitter-plate:12
